# Autodesk Inventor assembly: PCB_v3.6
(part 2 of 2)
- C:\Users\8326d\Downloads\PCB_v3.6\PCB_v3.6\User_Library-DFN5x6_SO8FL_Extruded_3_20.ipt
- C:\Users\8326d\Downloads\PCB_v3.6\PCB_v3.6\User_Library-DFN5x6_SO8FL_Extruded_4_20.ipt
- C:\Users\8326d\Downloads\PCB_v3.6\PCB_v3.6\User_Library-DFN5x6_SO8FL_Extruded_5_80.ipt
- C:\Users\8326d\Downloads\PCB_v3.6\PCB_v3.6\User_Library-DFN5x6_SO8FL_Extruded_5_81.ipt
- C:\Users\8326d\Downloads\PCB_v3.6\PCB_v3.6\User_Library-DFN5x6_SO8FL_Extruded_5_82.ipt
- C:\Users\8326d\Downloads\PCB_v3.6\PCB_v3.6\User_Library-DFN5x6_SO8FL_Extruded_5_83.ipt
- C:\Users\8326d\Downloads\PCB_v3.6\PCB_v3.6\User_Library-DFN5x6_SO8FL_Extruded_6_20.ipt
- C:\Users\8326d\Downloads\PCB_v3.6\PCB_v3.6\User_Library-DFN5x6_SO8FL_Extruded_42.ipt
- C:\Users\8326d\Downloads\PCB_v3.6\PCB_v3.6\User_Library-DFN5x6_SO8FL_Extruded_2_42.ipt
- C:\Users\8326d\Downloads\PCB_v3.6\PCB_v3.6\User_Library-DFN5x6_SO8FL_Extruded_2_43.ipt
- C:\Users\8326d\Downloads\PCB_v3.6\PCB_v3.6\User_Library-DFN5x6_SO8FL_Extruded_43.ipt
- C:\Users\8326d\Downloads\PCB_v3.6\PCB_v3.6\User_Library-DFN5x6_SO8FL_Cylinder_21.ipt
- C:\Users\8326d\Downloads\PCB_v3.6\PCB_v3.6\User_Library-DFN5x6_SO8FL_Extruded_3_21.ipt
- C:\Users\8326d\Downloads\PCB_v3.6\PCB_v3.6\User_Library-DFN5x6_SO8FL_Extruded_4_21.ipt
- C:\Users\8326d\Downloads\PCB_v3.6\PCB_v3.6\User_Library-DFN5x6_SO8FL_Extruded_5_84.ipt
- C:\Users\8326d\Downloads\PCB_v3.6\PCB_v3.6\User_Library-DFN5x6_SO8FL_Extruded_5_85.ipt
- C:\Users\8326d\Downloads\PCB_v3.6\PCB_v3.6\User_Library-DFN5x6_SO8FL_Extruded_5_86.ipt
- C:\Users\8326d\Downloads\PCB_v3.6\PCB_v3.6\User_Library-DFN5x6_SO8FL_Extruded_5_87.ipt
- C:\Users\8326d\Downloads\PCB_v3.6\PCB_v3.6\User_Library-DFN5x6_SO8FL_Extruded_6_21.ipt
- C:\Users\8326d\Downloads\PCB_v3.6\PCB_v3.6\User_Library-DFN5x6_SO8FL_Extruded_44.ipt
- C:\Users\8326d\Downloads\PCB_v3.6\PCB_v3.6\User_Library-DFN5x6_SO8FL_Extruded_2_44.ipt
- C:\Users\8326d\Downloads\PCB_v3.6\PCB_v3.6\User_Library-DFN5x6_SO8FL_Extruded_2_45.ipt
- C:\Users\8326d\Downloads\PCB_v3.6\PCB_v3.6\User_Library-DFN5x6_SO8FL_Extruded_45.ipt
- C:\Users\8326d\Downloads\PCB_v3.6\PCB_v3.6\User_Library-DFN5x6_SO8FL_Cylinder_22.ipt
- C:\Users\8326d\Downloads\PCB_v3.6\PCB_v3.6\User_Library-DFN5x6_SO8FL_Extruded_3_22.ipt
- C:\Users\8326d\Downloads\PCB_v3.6\PCB_v3.6\User_Library-DFN5x6_SO8FL_Extruded_4_22.ipt
- C:\Users\8326d\Downloads\PCB_v3.6\PCB_v3.6\User_Library-DFN5x6_SO8FL_Extruded_5_88.ipt
- C:\Users\8326d\Downloads\PCB_v3.6\PCB_v3.6\User_Library-DFN5x6_SO8FL_Extruded_5_89.ipt
- C:\Users\8326d\Downloads\PCB_v3.6\PCB_v3.6\User_Library-DFN5x6_SO8FL_Extruded_5_90.ipt
- C:\Users\8326d\Downloads\PCB_v3.6\PCB_v3.6\User_Library-DFN5x6_SO8FL_Extruded_5_91.ipt
- C:\Users\8326d\Downloads\PCB_v3.6\PCB_v3.6\User_Library-DFN5x6_SO8FL_Extruded_6_22.ipt
- C:\Users\8326d\Downloads\PCB_v3.6\PCB_v3.6\User_Library-DFN5x6_SO8FL_Extruded_46.ipt
- C:\Users\8326d\Downloads\PCB_v3.6\PCB_v3.6\User_Library-DFN5x6_SO8FL_Extruded_2_46.ipt
- C:\Users\8326d\Downloads\PCB_v3.6\PCB_v3.6\User_Library-DFN5x6_SO8FL_Extruded_2_47.ipt
- C:\Users\8326d\Downloads\PCB_v3.6\PCB_v3.6\User_Library-DFN5x6_SO8FL_Extruded_47.ipt
- C:\Users\8326d\Downloads\PCB_v3.6\PCB_v3.6\User_Library-DFN5x6_SO8FL_Cylinder_23.ipt
- C:\Users\8326d\Downloads\PCB_v3.6\PCB_v3.6\User_Library-DFN5x6_SO8FL_Extruded_3_23.ipt
- C:\Users\8326d\Downloads\PCB_v3.6\PCB_v3.6\User_Library-DFN5x6_SO8FL_Extruded_4_23.ipt
- C:\Users\8326d\Downloads\PCB_v3.6\PCB_v3.6\User_Library-DFN5x6_SO8FL_Extruded_5_92.ipt
- C:\Users\8326d\Downloads\PCB_v3.6\PCB_v3.6\User_Library-DFN5x6_SO8FL_Extruded_5_93.ipt
- C:\Users\8326d\Downloads\PCB_v3.6\PCB_v3.6\User_Library-DFN5x6_SO8FL_Extruded_5_94.ipt
- C:\Users\8326d\Downloads\PCB_v3.6\PCB_v3.6\User_Library-DFN5x6_SO8FL_Extruded_5_95.ipt
- C:\Users\8326d\Downloads\PCB_v3.6\PCB_v3.6\User_Library-DFN5x6_SO8FL_Extruded_6_23.ipt
- C:\Users\8326d\Downloads\PCB_v3.6\PCB_v3.6\User_Library-DFN5x6_SO8FL_Extruded_48.ipt
- C:\Users\8326d\Downloads\PCB_v3.6\PCB_v3.6\User_Library-DFN5x6_SO8FL_Extruded_2_48.ipt
- C:\Users\8326d\Downloads\PCB_v3.6\PCB_v3.6\User_Library-DFN5x6_SO8FL_Extruded_2_49.ipt
- C:\Users\8326d\Downloads\PCB_v3.6\PCB_v3.6\User_Library-DFN5x6_SO8FL_Extruded_49.ipt
- C:\Users\8326d\Downloads\PCB_v3.6\PCB_v3.6\User_Library-DFN5x6_SO8FL_Cylinder_24.ipt
- C:\Users\8326d\Downloads\PCB_v3.6\PCB_v3.6\User_Library-DFN5x6_SO8FL_Extruded_3_24.ipt
- C:\Users\8326d\Downloads\PCB_v3.6\PCB_v3.6\User_Library-DFN5x6_SO8FL_Extruded_4_24.ipt
- C:\Users\8326d\Downloads\PCB_v3.6\PCB_v3.6\User_Library-DFN5x6_SO8FL_Extruded_5_96.ipt
- C:\Users\8326d\Downloads\PCB_v3.6\PCB_v3.6\User_Library-DFN5x6_SO8FL_Extruded_5_97.ipt
- C:\Users\8326d\Downloads\PCB_v3.6\PCB_v3.6\User_Library-DFN5x6_SO8FL_Extruded_5_98.ipt
- C:\Users\8326d\Downloads\PCB_v3.6\PCB_v3.6\User_Library-DFN5x6_SO8FL_Extruded_5_99.ipt
- C:\Users\8326d\Downloads\PCB_v3.6\PCB_v3.6\User_Library-DFN5x6_SO8FL_Extruded_6_24.ipt
- C:\Users\8326d\Downloads\PCB_v3.6\PCB_v3.6\User_Library-DFN5x6_SO8FL_Extruded_50.ipt
- C:\Users\8326d\Downloads\PCB_v3.6\PCB_v3.6\User_Library-DFN5x6_SO8FL_Extruded_2_50.ipt
- C:\Users\8326d\Downloads\PCB_v3.6\PCB_v3.6\User_Library-DFN5x6_SO8FL_Extruded_2_51.ipt
- C:\Users\8326d\Downloads\PCB_v3.6\PCB_v3.6\User_Library-DFN5x6_SO8FL_Extruded_51.ipt
- C:\Users\8326d\Downloads\PCB_v3.6\PCB_v3.6\User_Library-DFN5x6_SO8FL_Cylinder_25.ipt
- C:\Users\8326d\Downloads\PCB_v3.6\PCB_v3.6\User_Library-DFN5x6_SO8FL_Extruded_3_25.ipt
- C:\Users\8326d\Downloads\PCB_v3.6\PCB_v3.6\User_Library-DFN5x6_SO8FL_Extruded_4_25.ipt
- C:\Users\8326d\Downloads\PCB_v3.6\PCB_v3.6\User_Library-DFN5x6_SO8FL_Extruded_5_100.ipt
- C:\Users\8326d\Downloads\PCB_v3.6\PCB_v3.6\User_Library-DFN5x6_SO8FL_Extruded_5_101.ipt
- C:\Users\8326d\Downloads\PCB_v3.6\PCB_v3.6\User_Library-DFN5x6_SO8FL_Extruded_5_102.ipt
- C:\Users\8326d\Downloads\PCB_v3.6\PCB_v3.6\User_Library-DFN5x6_SO8FL_Extruded_5_103.ipt
- C:\Users\8326d\Downloads\PCB_v3.6\PCB_v3.6\User_Library-DFN5x6_SO8FL_Extruded_6_25.ipt
- C:\Users\8326d\Downloads\PCB_v3.6\PCB_v3.6\User_Library-DFN5x6_SO8FL_Extruded_52.ipt
- C:\Users\8326d\Downloads\PCB_v3.6\PCB_v3.6\User_Library-DFN5x6_SO8FL_Extruded_2_52.ipt
- C:\Users\8326d\Downloads\PCB_v3.6\PCB_v3.6\User_Library-DFN5x6_SO8FL_Extruded_2_53.ipt
- C:\Users\8326d\Downloads\PCB_v3.6\PCB_v3.6\User_Library-DFN5x6_SO8FL_Extruded_53.ipt
- C:\Users\8326d\Downloads\PCB_v3.6\PCB_v3.6\User_Library-DFN5x6_SO8FL_Cylinder_26.ipt
- C:\Users\8326d\Downloads\PCB_v3.6\PCB_v3.6\User_Library-DFN5x6_SO8FL_Extruded_3_26.ipt
- C:\Users\8326d\Downloads\PCB_v3.6\PCB_v3.6\User_Library-DFN5x6_SO8FL_Extruded_4_26.ipt
- C:\Users\8326d\Downloads\PCB_v3.6\PCB_v3.6\User_Library-DFN5x6_SO8FL_Extruded_5_104.ipt
- C:\Users\8326d\Downloads\PCB_v3.6\PCB_v3.6\User_Library-DFN5x6_SO8FL_Extruded_5_105.ipt
- C:\Users\8326d\Downloads\PCB_v3.6\PCB_v3.6\User_Library-DFN5x6_SO8FL_Extruded_5_106.ipt
- C:\Users\8326d\Downloads\PCB_v3.6\PCB_v3.6\User_Library-DFN5x6_SO8FL_Extruded_5_107.ipt
- C:\Users\8326d\Downloads\PCB_v3.6\PCB_v3.6\User_Library-DFN5x6_SO8FL_Extruded_6_26.ipt
- C:\Users\8326d\Downloads\PCB_v3.6\PCB_v3.6\User_Library-DFN5x6_SO8FL_Extruded_54.ipt
- C:\Users\8326d\Downloads\PCB_v3.6\PCB_v3.6\User_Library-DFN5x6_SO8FL_Extruded_2_54.ipt
- C:\Users\8326d\Downloads\PCB_v3.6\PCB_v3.6\User_Library-DFN5x6_SO8FL_Extruded_2_55.ipt
- C:\Users\8326d\Downloads\PCB_v3.6\PCB_v3.6\User_Library-DFN5x6_SO8FL_Extruded_55.ipt
- C:\Users\8326d\Downloads\PCB_v3.6\PCB_v3.6\User_Library-DFN5x6_SO8FL_Cylinder_27.ipt
- C:\Users\8326d\Downloads\PCB_v3.6\PCB_v3.6\User_Library-DFN5x6_SO8FL_Extruded_3_27.ipt
- C:\Users\8326d\Downloads\PCB_v3.6\PCB_v3.6\User_Library-DFN5x6_SO8FL_Extruded_4_27.ipt
- C:\Users\8326d\Downloads\PCB_v3.6\PCB_v3.6\User_Library-DFN5x6_SO8FL_Extruded_5_108.ipt
- C:\Users\8326d\Downloads\PCB_v3.6\PCB_v3.6\User_Library-DFN5x6_SO8FL_Extruded_5_109.ipt
- C:\Users\8326d\Downloads\PCB_v3.6\PCB_v3.6\User_Library-DFN5x6_SO8FL_Extruded_5_110.ipt
- C:\Users\8326d\Downloads\PCB_v3.6\PCB_v3.6\User_Library-DFN5x6_SO8FL_Extruded_5_111.ipt
- C:\Users\8326d\Downloads\PCB_v3.6\PCB_v3.6\User_Library-DFN5x6_SO8FL_Extruded_6_27.ipt
- C:\Users\8326d\Downloads\PCB_v3.6\PCB_v3.6\RES_0603_(1608_metric)_37.ipt
- C:\Users\8326d\Downloads\PCB_v3.6\PCB_v3.6\RES_0603_(1608_metric)_38.ipt
- C:\Users\8326d\Downloads\PCB_v3.6\PCB_v3.6\RES_0603_(1608_metric)_39.ipt
- C:\Users\8326d\Downloads\PCB_v3.6\PCB_v3.6\RES_0603_(1608_metric)_40.ipt
- C:\Users\8326d\Downloads\PCB_v3.6\PCB_v3.6\RES_0603_(1608_metric)_41.ipt
- C:\Users\8326d\Downloads\PCB_v3.6\PCB_v3.6\RES_0603_(1608_metric)_42.ipt
- C:\Users\8326d\Downloads\PCB_v3.6\PCB_v3.6\RES_0603_(1608_metric)_43.ipt
- C:\Users\8326d\Downloads\PCB_v3.6\PCB_v3.6\RES_0603_(1608_metric)_44.ipt
- C:\Users\8326d\Downloads\PCB_v3.6\PCB_v3.6\RES_0603_(1608_metric)_45.ipt
- C:\Users\8326d\Downloads\PCB_v3.6\PCB_v3.6\Extruded_4_6.ipt
- C:\Users\8326d\Downloads\PCB_v3.6\PCB_v3.6\Extruded_2_8.ipt
- C:\Users\8326d\Downloads\PCB_v3.6\PCB_v3.6\Extruded_5_5.ipt
- C:\Users\8326d\Downloads\PCB_v3.6\PCB_v3.6\Extruded_6_5.ipt
- C:\Users\8326d\Downloads\PCB_v3.6\PCB_v3.6\Extruded_3_7.ipt
- C:\Users\8326d\Downloads\PCB_v3.6\PCB_v3.6\Extruded_7_5.ipt
- C:\Users\8326d\Downloads\PCB_v3.6\PCB_v3.6\RES_0603_(1608_metric)_46.ipt
- C:\Users\8326d\Downloads\PCB_v3.6\PCB_v3.6\Extruded_1_11.ipt
- C:\Users\8326d\Downloads\PCB_v3.6\PCB_v3.6\RES_0603_(1608_metric)_47.ipt
- C:\Users\8326d\Downloads\PCB_v3.6\PCB_v3.6\RES_0603_(1608_metric)_48.ipt
- C:\Users\8326d\Downloads\PCB_v3.6\PCB_v3.6\RES_0603_(1608_metric)_49.ipt
- C:\Users\8326d\Downloads\PCB_v3.6\PCB_v3.6\Extruded_24_3.ipt
- C:\Users\8326d\Downloads\PCB_v3.6\PCB_v3.6\Extruded_48_1.ipt
- C:\Users\8326d\Downloads\PCB_v3.6\PCB_v3.6\Extruded_49_1.ipt
- C:\Users\8326d\Downloads\PCB_v3.6\PCB_v3.6\Cylinder.ipt
- C:\Users\8326d\Downloads\PCB_v3.6\PCB_v3.6\Cylinder_1.ipt
- C:\Users\8326d\Downloads\PCB_v3.6\PCB_v3.6\Cylinder_1_1.ipt
- C:\Users\8326d\Downloads\PCB_v3.6\PCB_v3.6\LED_0603_APT1608_GREEN.ipt
- C:\Users\8326d\Downloads\PCB_v3.6\PCB_v3.6\RES_0603_(1608_metric)_50.ipt
- C:\Users\8326d\Downloads\PCB_v3.6\PCB_v3.6\RES_0603_(1608_metric)_51.ipt
- C:\Users\8326d\Downloads\PCB_v3.6\PCB_v3.6\RES_0603_(1608_metric)_52.ipt
- C:\Users\8326d\Downloads\PCB_v3.6\PCB_v3.6\CAPC3216X175N_-_1206_(3216_metric)_5.ipt
## Components (607 placed, 607 different names)
1. Open CASCADE STEP translator 6.8 1.1.1
2. CAPC3216X175N_-_1206_(3216_metric)
3. RES_0603_(1608_metric)
4. Extruded
5. Extruded_1
6. Extruded_2
7. CAPC3216X175N_-_1206_(3216_metric)_1
8. RES_0603_(1608_metric)_1
9. RES_0603_(1608_metric)_2
10. RES_0603_(1608_metric)_3
11. RES_0603_(1608_metric)_4
12. Extruded_3
13. Extruded_1_1
14. Extruded_4
15. Extruded_2_1
16. Extruded_3_1
17. Extruded_1_2
18. Extruded_2_2
19. Extruded_3_2
20. Extruded_1_3
21. Extruded_4_1
22. Extruded_5
23. Extruded_2_3
24. Open_CASCADE_STEP_translator_6.8_2.1
25. Open_CASCADE_STEP_translator_6.8_2.2.1
26. Leader
27. Leader_1
28. Leader_2
29. Leader_3
30. Extruded_4_2
31. Extruded_5_1
32. Extruded_2_4
33. Extruded_6
34. Extruded_7
35. Extruded_1_4
36. SOT23-5
37. Extruded_6_1
38. Extruded_7_1
39. Extruded_3_3
40. RES_0402_(1005_metric)
41. RES_0402_(1005_metric)_1
42. RES_0402_(1005_metric)_2
43. RES_0603_(1608_metric)_5
44. RES_0603_(1608_metric)_6
45. RES_0603_(1608_metric)_7
46. RES_0603_(1608_metric)_8
47. Extruded_3_4
48. Extruded_6_2
49. Extruded_7_2
50. Extruded_4_3
51. Extruded_8
52. Extruded_9
53. Extruded_4_4
54. Extruded_8_1
55. Extruded_9_1
56. Extruded_5_2
57. Extruded_10
58. Extruded_11
59. RES_0603_(1608_metric)_9
60. RES_0603_(1608_metric)_10
61. Extruded_12
62. Extruded_13
63. Extruded_14
64. Extruded_15
65. Extruded_16
66. SOT223-4
67. RES_0603_(1608_metric)_11
68. RES_0603_(1608_metric)_12
69. RES_0603_(1608_metric)_13
70. RES_0603_(1608_metric)_14
71. Extruded_17
72. Extruded_18
73. Extruded_1_5
74. Extruded_2_5
75. Extruded_1_6
76. Extruded_3_5
77. RES_0603_(1608_metric)_15
78. RES_0603_(1608_metric)_16
79. RES_0603_(1608_metric)_17
80. RES_0603_(1608_metric)_18
81. RES_0603_(1608_metric)_19
82. RES_0603_(1608_metric)_20
83. RES_0603_(1608_metric)_21
84. RES_0603_(1608_metric)_22
85. RES_0603_(1608_metric)_23
86. RES_0603_(1608_metric)_24
87. RES_0603_(1608_metric)_25
88. RES_0603_(1608_metric)_26
89. RES_0603_(1608_metric)_27
90. RES_0603_(1608_metric)_28
91. RES_0603_(1608_metric)_29
92. RES_0603_(1608_metric)_30
93. RES_0603_(1608_metric)_31
94. RES_0603_(1608_metric)_32
95. RES_0603_(1608_metric)_33
96. RES_0603_(1608_metric)_34
97. RES_0603_(1608_metric)_35
98. RES_0603_(1608_metric)_36
99. User_Library-DFN5x6_SO8FL_Extruded
100. User_Library-DFN5x6_SO8FL_Extruded_2
101. User_Library-DFN5x6_SO8FL_Extruded_2_1
102. User_Library-DFN5x6_SO8FL_Extruded_1
103. User_Library-DFN5x6_SO8FL_Cylinder
104. User_Library-DFN5x6_SO8FL_Extruded_3
105. User_Library-DFN5x6_SO8FL_Extruded_4
106. User_Library-DFN5x6_SO8FL_Extruded_5
107. User_Library-DFN5x6_SO8FL_Extruded_5_1
108. User_Library-DFN5x6_SO8FL_Extruded_5_2
109. User_Library-DFN5x6_SO8FL_Extruded_5_3
110. User_Library-DFN5x6_SO8FL_Extruded_6
111. User_Library-DFN5x6_SO8FL_Extruded_2_2
112. User_Library-DFN5x6_SO8FL_Extruded_2_2_1
113. User_Library-DFN5x6_SO8FL_Extruded_2_3
114. User_Library-DFN5x6_SO8FL_Extruded_3_1
115. User_Library-DFN5x6_SO8FL_Cylinder_1
116. User_Library-DFN5x6_SO8FL_Extruded_3_1_1
117. User_Library-DFN5x6_SO8FL_Extruded_4_1
118. User_Library-DFN5x6_SO8FL_Extruded_5_4
119. User_Library-DFN5x6_SO8FL_Extruded_5_5
120. User_Library-DFN5x6_SO8FL_Extruded_5_6
121. User_Library-DFN5x6_SO8FL_Extruded_5_7
122. User_Library-DFN5x6_SO8FL_Extruded_6_1
123. User_Library-DFN5x6_SO8FL_Extruded_4_2
124. User_Library-DFN5x6_SO8FL_Extruded_2_4
125. User_Library-DFN5x6_SO8FL_Extruded_2_5
126. User_Library-DFN5x6_SO8FL_Extruded_5_8
127. User_Library-DFN5x6_SO8FL_Cylinder_2
128. User_Library-DFN5x6_SO8FL_Extruded_3_2
129. User_Library-DFN5x6_SO8FL_Extruded_4_2_1
130. User_Library-DFN5x6_SO8FL_Extruded_5_8_1
131. User_Library-DFN5x6_SO8FL_Extruded_5_9
132. User_Library-DFN5x6_SO8FL_Extruded_5_10
133. User_Library-DFN5x6_SO8FL_Extruded_5_11
134. User_Library-DFN5x6_SO8FL_Extruded_6_2
135. User_Library-DFN5x6_SO8FL_Extruded_6_3
136. User_Library-DFN5x6_SO8FL_Extruded_2_6
137. User_Library-DFN5x6_SO8FL_Extruded_2_7
138. User_Library-DFN5x6_SO8FL_Extruded_7
139. User_Library-DFN5x6_SO8FL_Cylinder_3
140. User_Library-DFN5x6_SO8FL_Extruded_3_3
141. User_Library-DFN5x6_SO8FL_Extruded_4_3
142. User_Library-DFN5x6_SO8FL_Extruded_5_12
143. User_Library-DFN5x6_SO8FL_Extruded_5_13
144. User_Library-DFN5x6_SO8FL_Extruded_5_14
145. User_Library-DFN5x6_SO8FL_Extruded_5_15
146. User_Library-DFN5x6_SO8FL_Extruded_6_3_1
147. User_Library-DFN5x6_SO8FL_Extruded_8
148. User_Library-DFN5x6_SO8FL_Extruded_2_8
149. User_Library-DFN5x6_SO8FL_Extruded_2_9
150. User_Library-DFN5x6_SO8FL_Extruded_9
151. User_Library-DFN5x6_SO8FL_Cylinder_4
152. User_Library-DFN5x6_SO8FL_Extruded_3_4
153. User_Library-DFN5x6_SO8FL_Extruded_4_4
154. User_Library-DFN5x6_SO8FL_Extruded_5_16
155. User_Library-DFN5x6_SO8FL_Extruded_5_17
156. User_Library-DFN5x6_SO8FL_Extruded_5_18
157. User_Library-DFN5x6_SO8FL_Extruded_5_19
158. User_Library-DFN5x6_SO8FL_Extruded_6_4
159. User_Library-DFN5x6_SO8FL_Extruded_10
160. User_Library-DFN5x6_SO8FL_Extruded_2_10
161. User_Library-DFN5x6_SO8FL_Extruded_2_11
162. User_Library-DFN5x6_SO8FL_Extruded_11
163. User_Library-DFN5x6_SO8FL_Cylinder_5
164. User_Library-DFN5x6_SO8FL_Extruded_3_5
165. User_Library-DFN5x6_SO8FL_Extruded_4_5
166. User_Library-DFN5x6_SO8FL_Extruded_5_20
167. User_Library-DFN5x6_SO8FL_Extruded_5_21
168. User_Library-DFN5x6_SO8FL_Extruded_5_22
169. User_Library-DFN5x6_SO8FL_Extruded_5_23
170. User_Library-DFN5x6_SO8FL_Extruded_6_5
171. User_Library-DFN5x6_SO8FL_Extruded_12
172. User_Library-DFN5x6_SO8FL_Extruded_2_12
173. User_Library-DFN5x6_SO8FL_Extruded_2_13
174. User_Library-DFN5x6_SO8FL_Extruded_13
175. User_Library-DFN5x6_SO8FL_Cylinder_6
176. User_Library-DFN5x6_SO8FL_Extruded_3_6
177. User_Library-DFN5x6_SO8FL_Extruded_4_6
178. User_Library-DFN5x6_SO8FL_Extruded_5_24
179. User_Library-DFN5x6_SO8FL_Extruded_5_25
180. User_Library-DFN5x6_SO8FL_Extruded_5_26
181. User_Library-DFN5x6_SO8FL_Extruded_5_27
182. User_Library-DFN5x6_SO8FL_Extruded_6_6
183. User_Library-DFN5x6_SO8FL_Extruded_14
184. User_Library-DFN5x6_SO8FL_Extruded_2_14
185. User_Library-DFN5x6_SO8FL_Extruded_2_15
186. User_Library-DFN5x6_SO8FL_Extruded_15
187. User_Library-DFN5x6_SO8FL_Cylinder_7
188. User_Library-DFN5x6_SO8FL_Extruded_3_7
189. User_Library-DFN5x6_SO8FL_Extruded_4_7
190. User_Library-DFN5x6_SO8FL_Extruded_5_28
191. User_Library-DFN5x6_SO8FL_Extruded_5_29
192. User_Library-DFN5x6_SO8FL_Extruded_5_30
193. User_Library-DFN5x6_SO8FL_Extruded_5_31
194. User_Library-DFN5x6_SO8FL_Extruded_6_7
195. User_Library-DFN5x6_SO8FL_Extruded_16
196. User_Library-DFN5x6_SO8FL_Extruded_2_16
197. User_Library-DFN5x6_SO8FL_Extruded_2_17
198. User_Library-DFN5x6_SO8FL_Extruded_17
199. User_Library-DFN5x6_SO8FL_Cylinder_8
200. User_Library-DFN5x6_SO8FL_Extruded_3_8
201. User_Library-DFN5x6_SO8FL_Extruded_4_8
202. User_Library-DFN5x6_SO8FL_Extruded_5_32
203. User_Library-DFN5x6_SO8FL_Extruded_5_33
204. User_Library-DFN5x6_SO8FL_Extruded_5_34
205. User_Library-DFN5x6_SO8FL_Extruded_5_35
206. User_Library-DFN5x6_SO8FL_Extruded_6_8
207. User_Library-DFN5x6_SO8FL_Extruded_18
208. User_Library-DFN5x6_SO8FL_Extruded_2_18
209. User_Library-DFN5x6_SO8FL_Extruded_2_19
210. User_Library-DFN5x6_SO8FL_Extruded_19
211. User_Library-DFN5x6_SO8FL_Cylinder_9
212. User_Library-DFN5x6_SO8FL_Extruded_3_9
213. User_Library-DFN5x6_SO8FL_Extruded_4_9
214. User_Library-DFN5x6_SO8FL_Extruded_5_36
215. User_Library-DFN5x6_SO8FL_Extruded_5_37
216. User_Library-DFN5x6_SO8FL_Extruded_5_38
217. User_Library-DFN5x6_SO8FL_Extruded_5_39
218. User_Library-DFN5x6_SO8FL_Extruded_6_9
219. User_Library-DFN5x6_SO8FL_Extruded_20
220. User_Library-DFN5x6_SO8FL_Extruded_2_20
221. User_Library-DFN5x6_SO8FL_Extruded_2_21
222. User_Library-DFN5x6_SO8FL_Extruded_21
223. User_Library-DFN5x6_SO8FL_Cylinder_10
224. User_Library-DFN5x6_SO8FL_Extruded_3_10
225. User_Library-DFN5x6_SO8FL_Extruded_4_10
226. User_Library-DFN5x6_SO8FL_Extruded_5_40
227. User_Library-DFN5x6_SO8FL_Extruded_5_41
228. User_Library-DFN5x6_SO8FL_Extruded_5_42
229. User_Library-DFN5x6_SO8FL_Extruded_5_43
230. User_Library-DFN5x6_SO8FL_Extruded_6_10
231. User_Library-DFN5x6_SO8FL_Extruded_22
232. User_Library-DFN5x6_SO8FL_Extruded_2_22
233. User_Library-DFN5x6_SO8FL_Extruded_2_23
234. User_Library-DFN5x6_SO8FL_Extruded_23
235. User_Library-DFN5x6_SO8FL_Cylinder_11
236. User_Library-DFN5x6_SO8FL_Extruded_3_11
237. User_Library-DFN5x6_SO8FL_Extruded_4_11
238. User_Library-DFN5x6_SO8FL_Extruded_5_44
239. User_Library-DFN5x6_SO8FL_Extruded_5_45
240. User_Library-DFN5x6_SO8FL_Extruded_5_46
241. User_Library-DFN5x6_SO8FL_Extruded_5_47
242. User_Library-DFN5x6_SO8FL_Extruded_6_11
243. User_Library-DFN5x6_SO8FL_Extruded_24
244. User_Library-DFN5x6_SO8FL_Extruded_2_24
245. User_Library-DFN5x6_SO8FL_Extruded_2_25
246. User_Library-DFN5x6_SO8FL_Extruded_25
247. User_Library-DFN5x6_SO8FL_Cylinder_12
248. User_Library-DFN5x6_SO8FL_Extruded_3_12
249. User_Library-DFN5x6_SO8FL_Extruded_4_12
250. User_Library-DFN5x6_SO8FL_Extruded_5_48
251. User_Library-DFN5x6_SO8FL_Extruded_5_49
252. User_Library-DFN5x6_SO8FL_Extruded_5_50
253. User_Library-DFN5x6_SO8FL_Extruded_5_51
254. User_Library-DFN5x6_SO8FL_Extruded_6_12
255. User_Library-DFN5x6_SO8FL_Extruded_26
256. User_Library-DFN5x6_SO8FL_Extruded_2_26
257. User_Library-DFN5x6_SO8FL_Extruded_2_27
258. User_Library-DFN5x6_SO8FL_Extruded_27
259. User_Library-DFN5x6_SO8FL_Cylinder_13
260. User_Library-DFN5x6_SO8FL_Extruded_3_13
261. User_Library-DFN5x6_SO8FL_Extruded_4_13
262. User_Library-DFN5x6_SO8FL_Extruded_5_52
263. User_Library-DFN5x6_SO8FL_Extruded_5_53
264. User_Library-DFN5x6_SO8FL_Extruded_5_54
265. User_Library-DFN5x6_SO8FL_Extruded_5_55
266. User_Library-DFN5x6_SO8FL_Extruded_6_13
267. User_Library-DFN5x6_SO8FL_Extruded_28
268. User_Library-DFN5x6_SO8FL_Extruded_2_28
269. User_Library-DFN5x6_SO8FL_Extruded_2_29
270. User_Library-DFN5x6_SO8FL_Extruded_29
271. User_Library-DFN5x6_SO8FL_Cylinder_14
272. User_Library-DFN5x6_SO8FL_Extruded_3_14
273. User_Library-DFN5x6_SO8FL_Extruded_4_14
274. User_Library-DFN5x6_SO8FL_Extruded_5_56
275. User_Library-DFN5x6_SO8FL_Extruded_5_57
276. User_Library-DFN5x6_SO8FL_Extruded_5_58
277. User_Library-DFN5x6_SO8FL_Extruded_5_59
278. User_Library-DFN5x6_SO8FL_Extruded_6_14
279. User_Library-DFN5x6_SO8FL_Extruded_30
280. User_Library-DFN5x6_SO8FL_Extruded_2_30
281. User_Library-DFN5x6_SO8FL_Extruded_2_31
282. User_Library-DFN5x6_SO8FL_Extruded_31
283. User_Library-DFN5x6_SO8FL_Cylinder_15
284. User_Library-DFN5x6_SO8FL_Extruded_3_15
285. User_Library-DFN5x6_SO8FL_Extruded_4_15
286. User_Library-DFN5x6_SO8FL_Extruded_5_60
287. User_Library-DFN5x6_SO8FL_Extruded_5_61
288. User_Library-DFN5x6_SO8FL_Extruded_5_62
289. User_Library-DFN5x6_SO8FL_Extruded_5_63
290. User_Library-DFN5x6_SO8FL_Extruded_6_15
291. Extruded_19
292. Extruded_20
293. Extruded_1_7
294. Extruded_21
295. Extruded_1_8
296. Extruded_5_3
297. Extruded_10_1
298. Extruded_11_1
299. Extruded_6_3
300. Extruded_12_1
301. Extruded_13_1
302. Extruded_6_4
303. Extruded_12_2
304. Extruded_13_2
305. Extruded_7_3
306. Extruded_14_1
307. Extruded_15_1
308. Extruded_8_2
309. Extruded_16_1
310. Extruded_17_1
311. CAPC3216X175N_-_1206_(3216_metric)_2
312. Extruded_9_2
313. Extruded_18_1
314. Extruded_19_1
315. Extruded_7_4
316. Extruded_14_2
317. Extruded_15_2
318. Extruded_8_3
319. Extruded_16_2
320. Extruded_17_2
321. Extruded_9_3
322. Extruded_18_2
323. Extruded_19_2
324. Extruded_10_2
325. Extruded_20_1
326. Extruded_21_1
327. Extruded_10_3
328. Extruded_20_2
329. Extruded_21_2
330. Extruded_11_2
331. Extruded_22
332. Extruded_23
333. Extruded_12_3
334. Extruded_24
335. Extruded_25
336. Extruded_26
337. Extruded_27
338. Extruded_1_9
339. Extruded_13_3
340. Extruded_26_1
341. Extruded_27_1
342. Extruded_14_3
343. Extruded_28
344. Extruded_29
345. Extruded_15_3
346. Extruded_30
347. Extruded_31
348. Extruded_16_3
349. Extruded_32
350. Extruded_33
351. Extruded_11_3
352. Extruded_22_1
353. Extruded_23_1
354. Extruded_17_3
355. Extruded_34
356. Extruded_35
357. Extruded_2_6
358. Extruded_3_6
359. Extruded_1_10
360. Extruded_4_5
361. Extruded_5_4
362. Extruded_2_7
363. CAP_Alum_Elec_Size_G
364. CAP_Alum_Elec_Size_G_1
365. CAP_Alum_Elec_Size_G_2
366. CAP_Alum_Elec_Size_G_3
367. CAP_Alum_Elec_Size_G_4
368. Extruded_12_4
369. Extruded_24_1
370. Extruded_25_1
371. Extruded_13_4
372. Extruded_26_2
373. Extruded_27_2
374. Extruded_14_4
375. Extruded_28_1
376. Extruded_29_1
377. Extruded_15_4
378. Extruded_30_1
379. Extruded_31_1
380. Extruded_16_4
381. Extruded_32_1
382. Extruded_33_1
383. Extruded_17_4
384. Extruded_34_1
385. Extruded_35_1
386. Extruded_18_3
387. Extruded_36
388. Extruded_37
389. Extruded_19_3
390. Extruded_38
391. Extruded_39
392. Extruded_20_3
393. Extruded_40
394. Extruded_41
395. Extruded_21_3
396. Extruded_42
397. Extruded_43
398. Extruded_22_2
399. Extruded_44
400. Extruded_45
401. CAP_Alum_Elec_Size_G_5
402. CAP_Alum_Elec_Size_G_6
403. CAP_Alum_Elec_Size_G_7
404. CAPC3216X175N_-_1206_(3216_metric)_3
405. Extruded_18_4
406. Extruded_36_1
407. Extruded_37_1
408. Extruded_19_4
409. Extruded_38_1
410. Extruded_39_1
411. Extruded_23_2
412. Extruded_46
413. Extruded_47
414. Extruded_20_4
415. Extruded_40_1
416. Extruded_41_1
417. Extruded_21_4
418. Extruded_42_1
419. Extruded_43_1
420. Extruded_22_3
421. Extruded_44_1
422. Extruded_45_1
423. Extruded_23_3
424. Extruded_46_1
425. Extruded_47_1
426. CAPC3216X175N_-_1206_(3216_metric)_4
427. Extruded_24_2
428. Extruded_48
429. Extruded_49
430. Extruded_25_2
431. Extruded_50
432. Extruded_51
433. User_Library-DFN5x6_SO8FL_Extruded_32
434. User_Library-DFN5x6_SO8FL_Extruded_2_32
435. User_Library-DFN5x6_SO8FL_Extruded_2_33
436. User_Library-DFN5x6_SO8FL_Extruded_33
437. User_Library-DFN5x6_SO8FL_Cylinder_16
438. User_Library-DFN5x6_SO8FL_Extruded_3_16
439. User_Library-DFN5x6_SO8FL_Extruded_4_16
440. User_Library-DFN5x6_SO8FL_Extruded_5_64
441. User_Library-DFN5x6_SO8FL_Extruded_5_65
442. User_Library-DFN5x6_SO8FL_Extruded_5_66
443. User_Library-DFN5x6_SO8FL_Extruded_5_67
444. User_Library-DFN5x6_SO8FL_Extruded_6_16
445. User_Library-DFN5x6_SO8FL_Extruded_34
446. User_Library-DFN5x6_SO8FL_Extruded_2_34
447. User_Library-DFN5x6_SO8FL_Extruded_2_35
448. User_Library-DFN5x6_SO8FL_Extruded_35
449. User_Library-DFN5x6_SO8FL_Cylinder_17
450. User_Library-DFN5x6_SO8FL_Extruded_3_17
451. User_Library-DFN5x6_SO8FL_Extruded_4_17
452. User_Library-DFN5x6_SO8FL_Extruded_5_68
453. User_Library-DFN5x6_SO8FL_Extruded_5_69
454. User_Library-DFN5x6_SO8FL_Extruded_5_70
455. User_Library-DFN5x6_SO8FL_Extruded_5_71
456. User_Library-DFN5x6_SO8FL_Extruded_6_17
457. User_Library-DFN5x6_SO8FL_Extruded_36
458. User_Library-DFN5x6_SO8FL_Extruded_2_36
459. User_Library-DFN5x6_SO8FL_Extruded_2_37
460. User_Library-DFN5x6_SO8FL_Extruded_37
461. User_Library-DFN5x6_SO8FL_Cylinder_18
462. User_Library-DFN5x6_SO8FL_Extruded_3_18
463. User_Library-DFN5x6_SO8FL_Extruded_4_18
464. User_Library-DFN5x6_SO8FL_Extruded_5_72
465. User_Library-DFN5x6_SO8FL_Extruded_5_73
466. User_Library-DFN5x6_SO8FL_Extruded_5_74
467. User_Library-DFN5x6_SO8FL_Extruded_5_75
468. User_Library-DFN5x6_SO8FL_Extruded_6_18
469. User_Library-DFN5x6_SO8FL_Extruded_38
470. User_Library-DFN5x6_SO8FL_Extruded_2_38
471. User_Library-DFN5x6_SO8FL_Extruded_2_39
472. User_Library-DFN5x6_SO8FL_Extruded_39
473. User_Library-DFN5x6_SO8FL_Cylinder_19
474. User_Library-DFN5x6_SO8FL_Extruded_3_19
475. User_Library-DFN5x6_SO8FL_Extruded_4_19
476. User_Library-DFN5x6_SO8FL_Extruded_5_76
477. User_Library-DFN5x6_SO8FL_Extruded_5_77
478. User_Library-DFN5x6_SO8FL_Extruded_5_78
479. User_Library-DFN5x6_SO8FL_Extruded_5_79
480. User_Library-DFN5x6_SO8FL_Extruded_6_19
481. User_Library-DFN5x6_SO8FL_Extruded_40
482. User_Library-DFN5x6_SO8FL_Extruded_2_40
483. User_Library-DFN5x6_SO8FL_Extruded_2_41
484. User_Library-DFN5x6_SO8FL_Extruded_41
485. User_Library-DFN5x6_SO8FL_Cylinder_20
486. User_Library-DFN5x6_SO8FL_Extruded_3_20
487. User_Library-DFN5x6_SO8FL_Extruded_4_20
488. User_Library-DFN5x6_SO8FL_Extruded_5_80
489. User_Library-DFN5x6_SO8FL_Extruded_5_81
490. User_Library-DFN5x6_SO8FL_Extruded_5_82
491. User_Library-DFN5x6_SO8FL_Extruded_5_83
492. User_Library-DFN5x6_SO8FL_Extruded_6_20
493. User_Library-DFN5x6_SO8FL_Extruded_42
494. User_Library-DFN5x6_SO8FL_Extruded_2_42
495. User_Library-DFN5x6_SO8FL_Extruded_2_43
496. User_Library-DFN5x6_SO8FL_Extruded_43
497. User_Library-DFN5x6_SO8FL_Cylinder_21
498. User_Library-DFN5x6_SO8FL_Extruded_3_21
499. User_Library-DFN5x6_SO8FL_Extruded_4_21
500. User_Library-DFN5x6_SO8FL_Extruded_5_84
501. User_Library-DFN5x6_SO8FL_Extruded_5_85
502. User_Library-DFN5x6_SO8FL_Extruded_5_86
503. User_Library-DFN5x6_SO8FL_Extruded_5_87
504. User_Library-DFN5x6_SO8FL_Extruded_6_21
505. User_Library-DFN5x6_SO8FL_Extruded_44
506. User_Library-DFN5x6_SO8FL_Extruded_2_44
507. User_Library-DFN5x6_SO8FL_Extruded_2_45
508. User_Library-DFN5x6_SO8FL_Extruded_45
509. User_Library-DFN5x6_SO8FL_Cylinder_22
510. User_Library-DFN5x6_SO8FL_Extruded_3_22
511. User_Library-DFN5x6_SO8FL_Extruded_4_22
512. User_Library-DFN5x6_SO8FL_Extruded_5_88
513. User_Library-DFN5x6_SO8FL_Extruded_5_89
514. User_Library-DFN5x6_SO8FL_Extruded_5_90
515. User_Library-DFN5x6_SO8FL_Extruded_5_91
516. User_Library-DFN5x6_SO8FL_Extruded_6_22
517. User_Library-DFN5x6_SO8FL_Extruded_46
518. User_Library-DFN5x6_SO8FL_Extruded_2_46
519. User_Library-DFN5x6_SO8FL_Extruded_2_47
520. User_Library-DFN5x6_SO8FL_Extruded_47
521. User_Library-DFN5x6_SO8FL_Cylinder_23
522. User_Library-DFN5x6_SO8FL_Extruded_3_23
523. User_Library-DFN5x6_SO8FL_Extruded_4_23
524. User_Library-DFN5x6_SO8FL_Extruded_5_92
525. User_Library-DFN5x6_SO8FL_Extruded_5_93
526. User_Library-DFN5x6_SO8FL_Extruded_5_94
527. User_Library-DFN5x6_SO8FL_Extruded_5_95
528. User_Library-DFN5x6_SO8FL_Extruded_6_23
529. User_Library-DFN5x6_SO8FL_Extruded_48
530. User_Library-DFN5x6_SO8FL_Extruded_2_48
531. User_Library-DFN5x6_SO8FL_Extruded_2_49
532. User_Library-DFN5x6_SO8FL_Extruded_49
533. User_Library-DFN5x6_SO8FL_Cylinder_24
534. User_Library-DFN5x6_SO8FL_Extruded_3_24
535. User_Library-DFN5x6_SO8FL_Extruded_4_24
536. User_Library-DFN5x6_SO8FL_Extruded_5_96
537. User_Library-DFN5x6_SO8FL_Extruded_5_97
538. User_Library-DFN5x6_SO8FL_Extruded_5_98
539. User_Library-DFN5x6_SO8FL_Extruded_5_99
540. User_Library-DFN5x6_SO8FL_Extruded_6_24
541. User_Library-DFN5x6_SO8FL_Extruded_50
542. User_Library-DFN5x6_SO8FL_Extruded_2_50
543. User_Library-DFN5x6_SO8FL_Extruded_2_51
544. User_Library-DFN5x6_SO8FL_Extruded_51
545. User_Library-DFN5x6_SO8FL_Cylinder_25
546. User_Library-DFN5x6_SO8FL_Extruded_3_25
547. User_Library-DFN5x6_SO8FL_Extruded_4_25
548. User_Library-DFN5x6_SO8FL_Extruded_5_100
549. User_Library-DFN5x6_SO8FL_Extruded_5_101
550. User_Library-DFN5x6_SO8FL_Extruded_5_102
551. User_Library-DFN5x6_SO8FL_Extruded_5_103
552. User_Library-DFN5x6_SO8FL_Extruded_6_25
553. User_Library-DFN5x6_SO8FL_Extruded_52
554. User_Library-DFN5x6_SO8FL_Extruded_2_52
555. User_Library-DFN5x6_SO8FL_Extruded_2_53
556. User_Library-DFN5x6_SO8FL_Extruded_53
557. User_Library-DFN5x6_SO8FL_Cylinder_26
558. User_Library-DFN5x6_SO8FL_Extruded_3_26
559. User_Library-DFN5x6_SO8FL_Extruded_4_26
560. User_Library-DFN5x6_SO8FL_Extruded_5_104
561. User_Library-DFN5x6_SO8FL_Extruded_5_105
562. User_Library-DFN5x6_SO8FL_Extruded_5_106
563. User_Library-DFN5x6_SO8FL_Extruded_5_107
564. User_Library-DFN5x6_SO8FL_Extruded_6_26
565. User_Library-DFN5x6_SO8FL_Extruded_54
566. User_Library-DFN5x6_SO8FL_Extruded_2_54
567. User_Library-DFN5x6_SO8FL_Extruded_2_55
568. User_Library-DFN5x6_SO8FL_Extruded_55
569. User_Library-DFN5x6_SO8FL_Cylinder_27
570. User_Library-DFN5x6_SO8FL_Extruded_3_27
571. User_Library-DFN5x6_SO8FL_Extruded_4_27
572. User_Library-DFN5x6_SO8FL_Extruded_5_108
573. User_Library-DFN5x6_SO8FL_Extruded_5_109
574. User_Library-DFN5x6_SO8FL_Extruded_5_110
575. User_Library-DFN5x6_SO8FL_Extruded_5_111
576. User_Library-DFN5x6_SO8FL_Extruded_6_27
577. RES_0603_(1608_metric)_37
578. RES_0603_(1608_metric)_38
579. RES_0603_(1608_metric)_39
580. RES_0603_(1608_metric)_40
581. RES_0603_(1608_metric)_41
582. RES_0603_(1608_metric)_42
583. RES_0603_(1608_metric)_43
584. RES_0603_(1608_metric)_44
585. RES_0603_(1608_metric)_45
586. Extruded_4_6
587. Extruded_2_8
588. Extruded_5_5
589. Extruded_6_5
590. Extruded_3_7
591. Extruded_7_5
592. RES_0603_(1608_metric)_46
593. Extruded_1_11
594. RES_0603_(1608_metric)_47
595. RES_0603_(1608_metric)_48
596. RES_0603_(1608_metric)_49
597. Extruded_24_3
598. Extruded_48_1
599. Extruded_49_1
600. Cylinder
601. Cylinder_1
602. Cylinder_1_1
603. LED_0603_APT1608_GREEN
604. RES_0603_(1608_metric)_50
605. RES_0603_(1608_metric)_51
606. RES_0603_(1608_metric)_52
607. CAPC3216X175N_-_1206_(3216_metric)_5
